# Autodesk Inventor assembly: Biegelehre
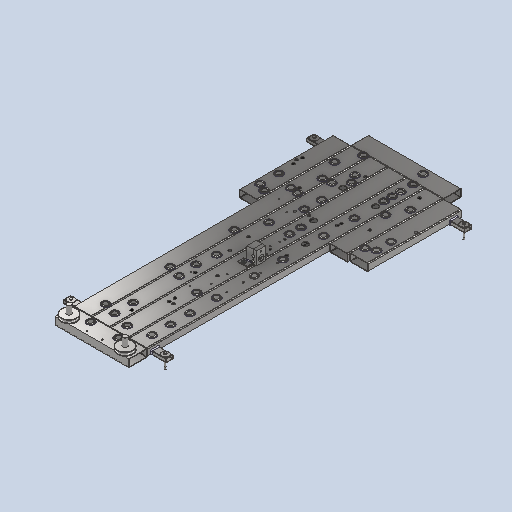
[picture p0: Inventor's stored thumbnail of the model, 512x512]
Saved by Autodesk Inventor 2027.1 (Build 311270010, 270A)
## iProperties
Created: 2026-07-29
Part Number: Biegelehre
Document SubType Name: Weldment
Designer: moest
Weld Material: Welded Aluminum-6061
Author: moest
## Documents named in this file (7)
- C:\Users\moest\Downloads\Biegelehre.iam
- C:\Users\moest\Downloads\Baugruppe1.iam
- C:\Users\moest\Downloads\Einspannvorrichtung.iam
- C:\Users\moest\Downloads\Anschweißlasche.iam
- C:\Users\moest\Documents\Inventor\Content Center Files\R2027\de-DE\ISO 14583\ISO 14583 - M10x14-4.8.ipt
- C:\Users\moest\Downloads\Biegerolle 66.ipt
- C:\Users\moest\Downloads\Bolzen.ipt
## Components (12 placed, 6 different names)
1. Baugruppe1:2 [sub-assembly] — Passend:1, Fluchtend:1, Fluchtend:2, Passend:2, Fluchtend:3, Fluchtend:4, Passend:3, Fluchtend:5, Fluchtend:6, Passend:4, Fluchtend:7, Fluchtend:8, Passend:5, Passend:6, Passend:7, Passend:8, Passend:9, Passend:11, Passend:12, Passend:14, Passend:15
2. Einspannvorrichtung:1 [sub-assembly] — Passend:5, Passend:6, Passend:7, Einfügen:1, Einfügen:2
3. Anschweißlasche:1 [sub-assembly] — Passend:1, Fluchtend:1, Fluchtend:2
4. Anschweißlasche:2 [sub-assembly] — Passend:2, Fluchtend:3, Fluchtend:4
5. Anschweißlasche:3 [sub-assembly] — Passend:4, Fluchtend:7, Fluchtend:8
6. Anschweißlasche:4 [sub-assembly] — Passend:3, Fluchtend:5, Fluchtend:6
7. Schraube ISO 14583:2011(E) M10x14-4.8:1 — Einfügen:1
8. Schraube ISO 14583:2011(E) M10x14-4.8:2 — Einfügen:2
9. Biegerolle 66:1 — Passend:10, Passend:11
10. Bolzen:1 — Passend:8, Passend:9, Passend:10
11. Bolzen:2 — Passend:12, Passend:13, Passend:14
12. Biegerolle 66:2 — Passend:13, Passend:15
## Relationships (25: Mate 15, Flush 8, Insert 2)
- Passend:1 [Mate]: Baugruppe1:2 ↔ Anschweißlasche:1
- Fluchtend:1 [Flush]: Baugruppe1:2 ↔ Anschweißlasche:1
- Fluchtend:2 [Flush] (122 mm): Baugruppe1:2 ↔ Anschweißlasche:1
- Passend:2 [Mate]: Baugruppe1:2 ↔ Anschweißlasche:2
- Fluchtend:3 [Flush]: Baugruppe1:2 ↔ Anschweißlasche:2
- Fluchtend:4 [Flush] (-122 mm): Baugruppe1:2 ↔ Anschweißlasche:2
- Passend:3 [Mate]: Baugruppe1:2 ↔ Anschweißlasche:4
- Fluchtend:5 [Flush]: Baugruppe1:2 ↔ Anschweißlasche:4
- Fluchtend:6 [Flush] (122 mm): Baugruppe1:2 ↔ Anschweißlasche:4
- Passend:4 [Mate]: Baugruppe1:2 ↔ Anschweißlasche:3
- Fluchtend:7 [Flush]: Baugruppe1:2 ↔ Anschweißlasche:3
- Fluchtend:8 [Flush] (122 mm): Baugruppe1:2 ↔ Anschweißlasche:3
- Passend:5 [Mate]: Baugruppe1:2 ↔ Einspannvorrichtung:1
- Passend:6 [Mate]: Baugruppe1:2 ↔ Einspannvorrichtung:1
- Passend:7 [Mate]: Baugruppe1:2 ↔ Einspannvorrichtung:1
- Einfügen:1 [Insert]: Einspannvorrichtung:1 ↔ Schraube ISO 14583:2011(E) M10x14-4.8:1
- Einfügen:2 [Insert]: Einspannvorrichtung:1 ↔ Schraube ISO 14583:2011(E) M10x14-4.8:2
- Passend:8 [Mate]: Baugruppe1:2 ↔ Bolzen:1
- Passend:9 [Mate]: Baugruppe1:2 ↔ Bolzen:1
- Passend:10 [Mate]: Biegerolle 66:1 ↔ Bolzen:1
- Passend:11 [Mate]: Baugruppe1:2 ↔ Biegerolle 66:1
- Passend:12 [Mate]: Baugruppe1:2 ↔ Bolzen:2
- Passend:13 [Mate]: Bolzen:2 ↔ Biegerolle 66:2
- Passend:14 [Mate]: Baugruppe1:2 ↔ Bolzen:2
- Passend:15 [Mate]: Baugruppe1:2 ↔ Biegerolle 66:2
